# Autodesk Inventor assembly: Gimbal_Motor
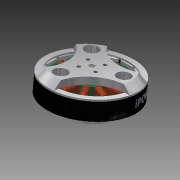
[picture p0: Inventor's stored thumbnail of the model, 180x180]
Saved by Autodesk Inventor 2013 (Build 170138000, 138)
## iProperties
Created: 2013-09-27
Part Number: Gimbal_Motor
Document SubType Name: Assembly
Designer: Hunter
Author: Hunter
## Documents named in this file (9)
- C:\Users\Hunter\Documents\Inventor\Bert_gimbal\Gimbal_Motor.iam
- C:\Users\Hunter\Documents\Inventor\Bert_gimbal\End_Mount.ipt
- C:\Users\Hunter\Documents\Inventor\Bert_gimbal\end_bell.ipt
- C:\Users\Hunter\Documents\Inventor\Bert_gimbal\MR693_ZZC.ipt
- C:\Users\Hunter\Documents\Inventor\Bert_gimbal\Shaft1.iam
- C:\Users\Hunter\Documents\Inventor\Content Center Files\R2013\en-US\ANSI B27.7(1)\ANSI B27.7 - 32.3(1).ipt
- C:\Users\Hunter\Documents\Inventor\Bert_gimbal\Magnets.ipt
- C:\Users\Hunter\Documents\Inventor\Bert_gimbal\Stator.ipt
- C:\Users\Hunter\Documents\Inventor\Bert_gimbal\Windings.ipt
## Components (8 placed, 8 different names)
1. End_Mount:1 — Mate:1, Mate:2, Insert:1, Angle:3
2. end_bell:1 — Mate:1, Mate:2, Flush:1, Mate:3, Insert:3, Angle:1, Flush:2, Flush:3
3. MR693_ZZC:1 — Insert:1
4. Shaft:2 [sub-assembly] — Flush:1, Mate:3, Insert:2
5. E-Ring 3:1 — Insert:2, Angle:2
6. Magnets:1 — Insert:3, Angle:1, Angle:2
7. Stator:1 — Flush:2, Flush:3, Flush:4, Flush:5, Mate:4, Angle:3
8. Windings:1 — Flush:4, Flush:5, Mate:4
## Relationships (15: Flush 5, Mate 4, Insert 3, Angle 3)
- Mate:1: End_Mount:1 ↔ end_bell:1
- Mate:2 (-22.5 mm): End_Mount:1 ↔ end_bell:1
- Insert:1: End_Mount:1 ↔ MR693_ZZC:1
- Flush:1: end_bell:1 ↔ Shaft:2
- Mate:3: end_bell:1 ↔ Shaft:2
- Insert:3: end_bell:1 ↔ Magnets:1
- Angle:1 (90 deg): end_bell:1 ↔ Magnets:1
- Angle:2 (0 deg): E-Ring 3:1 ↔ Magnets:1
- Flush:2: end_bell:1 ↔ Stator:1
- Flush:3 (2 mm): end_bell:1 ↔ Stator:1
- Flush:4: Stator:1 ↔ Windings:1
- Flush:5: Stator:1 ↔ Windings:1
- Mate:4: Stator:1 ↔ Windings:1
- Angle:3 (0 deg): End_Mount:1 ↔ Stator:1
- Insert:2: Shaft:2 ↔ E-Ring 3:1
